# Autodesk Inventor assembly: assembly_sterar_superior
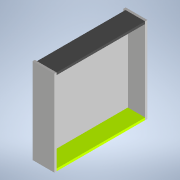
[picture p0: Inventor's stored thumbnail of the model, 180x180]
Saved by Autodesk Inventor 2022.6 (Build 266554000, 554)
## iProperties
RuleStatus: InUse
Created: 2026-10-23
Part Number: assembly_sterar_superior
Document SubType Name: Assembly
Designer: Dragos Macovei
Author: Dragos Macovei
## Documents named in this file (5)
- C:\Users\Dragos Macovei\Documents\3D_Parts\PAT ADI\assembly_sterar_superior.iam
- C:\Users\Dragos Macovei\Documents\3D_Parts\PAT ADI\sertar_superior_latime.ipt
- C:\Users\Dragos Macovei\Documents\3D_Parts\PAT ADI\sertar_superior_lungime.ipt
- C:\Users\Dragos Macovei\Documents\3D_Parts\PAT ADI\fund_sertar.ipt
- C:\Users\Dragos Macovei\Documents\3D_Parts\PAT ADI\sertar_superior_latime_parte_din_spate.ipt
## Components (5 placed, 4 different names)
1. sertar_superior_lungime:1 — Flush:3, Mate:2, Flush:5, Mate:4, Flush:8, Mate:6, Flush:10
2. sertar_superior_latime:2 — Mate:1, Flush:1, Flush:4, Mate:2, Flush:5, Mate:5
3. sertar_superior_lungime:2 — Mate:1, Flush:1, Flush:3, Flush:4, Flush:9
4. fund_sertar:1 — Mate:4, Mate:5, Flush:8
5. sertar_superior_latime_parte_din_spate:1 — Flush:9, Mate:6, Flush:10
## Relationships (12: Flush 7, Mate 5)
- Mate:1: sertar_superior_latime:2 ↔ sertar_superior_lungime:2
- Flush:1: sertar_superior_latime:2 ↔ sertar_superior_lungime:2
- Flush:3: sertar_superior_lungime:1 ↔ sertar_superior_lungime:2
- Flush:4: sertar_superior_latime:2 ↔ sertar_superior_lungime:2
- Mate:2: sertar_superior_lungime:1 ↔ sertar_superior_latime:2
- Flush:5: sertar_superior_lungime:1 ↔ sertar_superior_latime:2
- Mate:4: sertar_superior_lungime:1 ↔ fund_sertar:1
- Mate:5: sertar_superior_latime:2 ↔ fund_sertar:1
- Flush:8 (15 mm): sertar_superior_lungime:1 ↔ fund_sertar:1
- Flush:9: sertar_superior_lungime:2 ↔ sertar_superior_latime_parte_din_spate:1
- Mate:6: sertar_superior_lungime:1 ↔ sertar_superior_latime_parte_din_spate:1
- Flush:10: sertar_superior_lungime:1 ↔ sertar_superior_latime_parte_din_spate:1
